# Autodesk Inventor assembly: Main
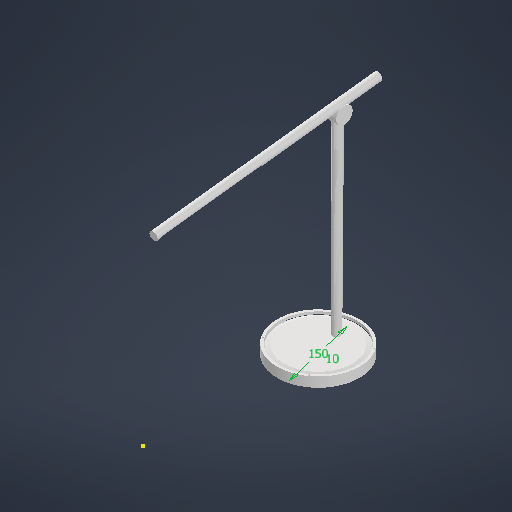
[picture p0: Inventor's stored thumbnail of the model, 512x512]
Saved by Autodesk Inventor 2027.1 (Build 311270010, 270A)
## iProperties
Created: 2026-11-24
Part Number: Main
Document SubType Name: Assembly
Designer: User
Author: User
## Documents named in this file (3)
- G:\Github\SmartRoom\Hardware\SmartRoom_Desk_lamp\Main.iam
- G:\Github\Suntracker\V2\Hardware\Parts\lamp\lamp.ipt
- G:\Github\SmartRoom\Hardware\SmartRoom_Desk_lamp\Parts\base.ipt
## Components (2 placed, 2 different names)
1. lamp:1 — Obrotowe:1
2. base:1 — Obrotowe:1
## Relationships (1: RevoluteJoint 1)
- Obrotowe:1 [RevoluteJoint]: lamp:1 ↔ base:1
